# Autodesk Inventor assembly: hayashi-setup-with-optics
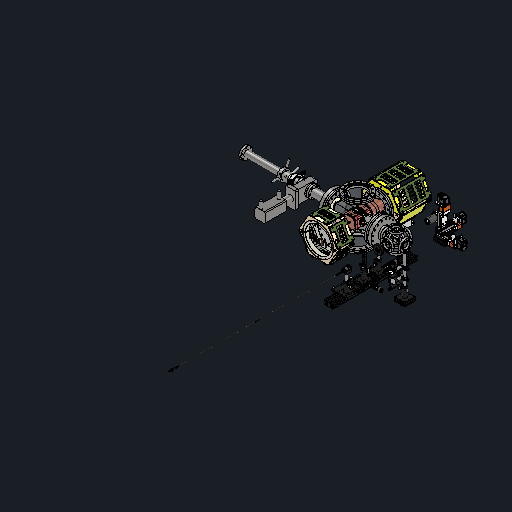
[picture p0: Inventor's stored thumbnail of the model, 512x512]
Saved by Autodesk Inventor 2027.1 (Build 311270010, 270A)
## iProperties
Created: 2025-07-13
Part Number: hayashi-setup-with-optics
Document SubType Name: Assembly
Designer: jin20
Author: jin20
## Documents named in this file (8)
- C:\Users\queezz\Dropbox\Drawings\pihti-cad\Hayashi-probe\hayashi-setup-with-optics.iam
- C:\Users\queezz\Dropbox\Drawings\pihti-cad\Plasma Vessel\Plasma-vessel-with-plasma-box.iam
- C:\Users\queezz\Dropbox\Drawings\pihti-cad\ContentCenter\CF-parts\CF70-nipple\cf70_hole_nipple.ipt
- C:\Users\queezz\Dropbox\Drawings\pihti-cad\staging\hayashi\SpectroscopySystem\vessel\mini-vessel.iam
- C:\Users\queezz\Dropbox\Drawings\pihti-cad\ContentCenter\CF-parts\CF-Flanges\CF_152-70.ipt
- C:\Users\queezz\Dropbox\Drawings\pihti-cad\staging\hayashi\SpectroscopySystem\ラマン分光系.iam
- C:\Users\queezz\Dropbox\Drawings\pihti-cad\staging\hayashi\SpectroscopySystem\高さ調整用ミラー.iam
- C:\Users\queezz\Dropbox\Drawings\pihti-cad\staging\hayashi\SpectroscopySystem\LIBS分光系.iam
## Components (7 placed, 7 different names)
1. Plasma-vessel-with-plasma-box:1 [sub-assembly] — Insert:5, Insert:6
2. cf70_hole_nipple:1 — Insert:3, Insert:4, Insert:7, Insert:8
3. mini-vessel:1 [sub-assembly] — Insert:7, Insert:8, Rigid:1, Mate:1
4. CF_152-70:1 — Insert:3, Insert:4, Insert:5, Insert:6
5. ラマン分光系:1 [sub-assembly] — Rigid:1, Angle:1
6. 高さ調整用ミラー:1 [sub-assembly]
7. LIBS分光系:1 [sub-assembly] — Mate:1, Angle:1
## Relationships (9: Insert 6, WeldJoint 1, Mate 1, Angle 1)
- Insert:3: cf70_hole_nipple:1 ↔ CF_152-70:1
- Insert:4: cf70_hole_nipple:1 ↔ CF_152-70:1
- Insert:5: Plasma-vessel-with-plasma-box:1 ↔ CF_152-70:1
- Insert:6: Plasma-vessel-with-plasma-box:1 ↔ CF_152-70:1
- Insert:7: cf70_hole_nipple:1 ↔ mini-vessel:1
- Insert:8: cf70_hole_nipple:1 ↔ mini-vessel:1
- Rigid:1 [WeldJoint] (40.208 mm): mini-vessel:1 ↔ ラマン分光系:1
- Mate:1: mini-vessel:1 ↔ LIBS分光系:1
- Angle:1 (0 deg): ラマン分光系:1 ↔ LIBS分光系:1
